# Autodesk Inventor assembly: robotfish_new_1
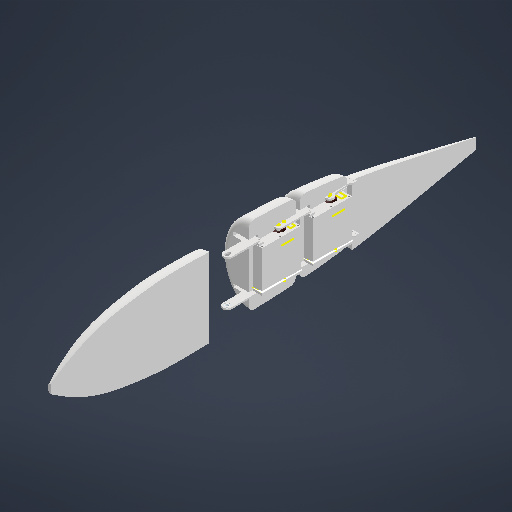
[picture p0: Inventor's stored thumbnail of the model, 512x512]
Saved by Autodesk Inventor 2027 (Build 310192060, 192F)
## iProperties
Created: 2026-08-14
Part Number: robotfish_new_1
Document SubType Name: Assembly
Designer: thita
Author: thita
## Documents named in this file (13)
- C:\Users\thita\ROBOT CÁ\ROBOTFISH_FINAL2\robotfish_new_1.iam
- C:\Users\thita\ROBOT CÁ\ROBOTFISH_FINAL2\main_body.ipt
- C:\Users\thita\Downloads\v3 hop\Workgroups\NotInProject\Assembly1.iam
- C:\Users\thita\Downloads\cáThanh tam giác 1.ipt
- C:\Users\thita\Downloads\cáthanh liên kết đuôi 1.ipt
- C:\Users\thita\Downloads\cáthanh liên kết đuôi 2.ipt
- C:\Users\thita\Downloads\cáthanh tam giác 2.ipt
- C:\Users\thita\ROBOT CÁ\ROBOTFISH_FINAL2\Part1.ipt
- C:\Users\thita\ROBOT CÁ\ROBOTFISH_FINAL2\tail.ipt
- C:\Users\thita\Downloads\Bearing 684-2Z (STEP AP214)\Bearing 684-2Z (STEP AP214).ipt
- C:\Users\thita\ROBOT CÁ\ROBOTFISH_FINAL2\segment_1.ipt
- C:\Users\thita\ROBOT CÁ\ROBOTFISH_FINAL2\segmeng_1.ipt
- C:\Users\thita\ROBOT CÁ\ROBOTFISH_FINAL2\segment_2.ipt
## Components (17 placed, 12 different names)
1. main_body:1
2. cáThanh tam giác 1:1 — Rigid:10
3. cáThanh tam giác 1:2 — Rigid:12
4. cáthanh liên kết đuôi 1:1 — Rotational:9
5. cáthanh liên kết đuôi 2:1 — Rotational:10
6. cáthanh tam giác 2:1 — Rotational:6, Rotational:7
7. cáthanh tam giác 2:2 — Rigid:11, Rotational:11
8. Part1:1
9. tail:1
10. Bearing 684-2Z (STEP AP214):1 — Rotational:7
11. Bearing 684-2Z (STEP AP214):2 — Rotational:8, Rotational:10
12. Bearing 684-2Z (STEP AP214):3 — Rotational:11
13. segment_1:1 — Rigid:8
14. segmeng_1:1
15. segment_2:1 — Rigid:9
16. Assembly1:8 [sub-assembly] — Rigid:8, Rotational:6, Rigid:11, Rigid:12
17. Assembly1:9 [sub-assembly] — Rigid:9, Rigid:10, Rotational:8, Rotational:9
## Relationships (11: RevoluteJoint 6, WeldJoint 5)
- Rigid:8 [WeldJoint]: segment_1:1 ↔ Assembly1:8
- Rigid:9 [WeldJoint]: segment_2:1 ↔ Assembly1:9
- Rotational:6 [RevoluteJoint]: cáthanh tam giác 2:1 ↔ Assembly1:8
- Rigid:10 [WeldJoint]: cáThanh tam giác 1:1 ↔ Assembly1:9
- Rotational:7 [RevoluteJoint]: cáthanh tam giác 2:1 ↔ Bearing 684-2Z (STEP AP214):1
- Rotational:8 [RevoluteJoint]: Bearing 684-2Z (STEP AP214):2 ↔ Assembly1:9
- Rotational:9 [RevoluteJoint]: cáthanh liên kết đuôi 1:1 ↔ Assembly1:9
- Rotational:10 [RevoluteJoint]: cáthanh liên kết đuôi 2:1 ↔ Bearing 684-2Z (STEP AP214):2
- Rigid:11 [WeldJoint]: cáthanh tam giác 2:2 ↔ Assembly1:8
- Rigid:12 [WeldJoint]: cáThanh tam giác 1:2 ↔ Assembly1:8
- Rotational:11 [RevoluteJoint]: cáthanh tam giác 2:2 ↔ Bearing 684-2Z (STEP AP214):3
